# Autodesk Inventor assembly: WarmanPrototype
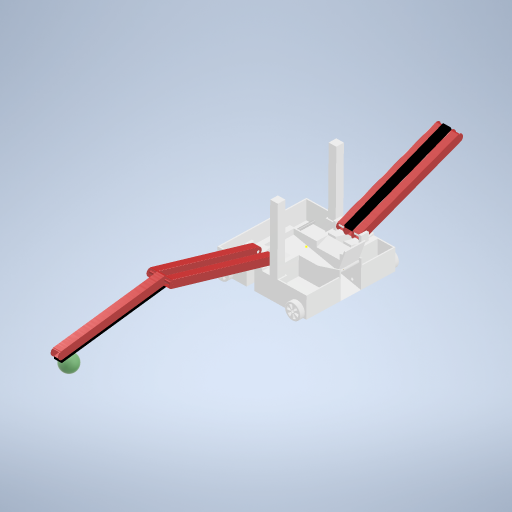
[picture p0: Inventor's stored thumbnail of the model, 512x512]
Saved by Autodesk Inventor 2023 (Build 270158000, 158)
## iProperties
Created: 2024-03-21
Part Number: WarmanPrototype
Document SubType Name: Assembly
Designer: BenFr
Mass: 2280.09 g
Surface Area: 19703.9 cm^2
Volume: 2220.94 cm^3
Density: 1.02663 g/cm^3
Author: BenFr
## Documents named in this file (11)
- C:\Users\BenFr\OneDrive\Documents\WarmanPrototype.iam
- C:\Users\BenFr\OneDrive\Documents\Body.ipt
- C:\Users\BenFr\OneDrive\Documents\BaseArms.ipt
- C:\Users\BenFr\OneDrive\Documents\UpperArm.ipt
- C:\Users\BenFr\OneDrive\Documents\FINAL WHEEL 235.ipt
- C:\Users\BenFr\OneDrive\Documents\RearAxle.ipt
- C:\Users\BenFr\OneDrive\Documents\Motor.ipt
- C:\Users\BenFr\OneDrive\Documents\Door.ipt
- C:\Users\BenFr\OneDrive\Documents\Velcro.ipt
- C:\Users\BenFr\OneDrive\Documents\BasePlate.ipt
- C:\Users\BenFr\OneDrive\Documents\Ball.ipt
## Components (22 placed, 10 different names)
1. Body:1 — Rotational:1, Rotational:3, Rotational:6, Rotational:9, Rotational:11, Rotational:12
2. BaseArms:1 — Rotational:1, Rotational:2
3. BaseArms:2 — Rotational:3, Rotational:4
4. UpperArm:1 — Rotational:4, Rigid:2
5. UpperArm:2 — Rotational:2, Rigid:1
6. FINAL WHEEL 235:1 — Rotational:8, Rotational:9
7. FINAL WHEEL 235:2 — Rotational:5, Rotational:6
8. FINAL WHEEL 235:3 — Rotational:10, Rotational:11
9. FINAL WHEEL 235:4 — Rotational:7
10. RearAxle:1 — Rotational:5, Rotational:7
11. Motor:1 — Rotational:8
12. Motor:2 — Rotational:10
13. Door:1 — Rotational:12
14. Velcro:1 — Rigid:1
15. Velcro:2 — Rigid:2
16. BasePlate:1
17. Ball:1
18. Ball:2
19. Ball:3
20. Ball:4
21. Ball:5
22. Ball:6
## Relationships (14: RevoluteJoint 12, WeldJoint 2)
- Rotational:1 [RevoluteJoint]: Body:1 ↔ BaseArms:1
- Rotational:2 [RevoluteJoint]: BaseArms:1 ↔ UpperArm:2
- Rotational:3 [RevoluteJoint]: Body:1 ↔ BaseArms:2
- Rotational:4 [RevoluteJoint]: BaseArms:2 ↔ UpperArm:1
- Rotational:5 [RevoluteJoint]: FINAL WHEEL 235:2 ↔ RearAxle:1
- Rotational:6 [RevoluteJoint]: Body:1 ↔ FINAL WHEEL 235:2
- Rotational:7 [RevoluteJoint]: FINAL WHEEL 235:4 ↔ RearAxle:1
- Rotational:8 [RevoluteJoint]: FINAL WHEEL 235:1 ↔ Motor:1
- Rotational:9 [RevoluteJoint]: Body:1 ↔ FINAL WHEEL 235:1
- Rotational:10 [RevoluteJoint]: FINAL WHEEL 235:3 ↔ Motor:2
- Rotational:11 [RevoluteJoint]: Body:1 ↔ FINAL WHEEL 235:3
- Rotational:12 [RevoluteJoint]: Body:1 ↔ Door:1
- Rigid:1 [WeldJoint]: UpperArm:2 ↔ Velcro:1
- Rigid:2 [WeldJoint]: UpperArm:1 ↔ Velcro:2
